# Autodesk Inventor assembly: balustrada_pe_patrat
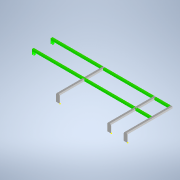
[picture p0: Inventor's stored thumbnail of the model, 180x180]
Saved by Autodesk Inventor 2022.6 (Build 266554000, 554)
## iProperties
Created: 2026-11-03
Part Number: balustrada_pe_patrat
Document SubType Name: Assembly
Designer: Dragos Macovei
Author: Dragos Macovei
## Documents named in this file (3)
- C:\Users\Dragos Macovei\Documents\3D_Parts\PAT ADI\balustrada_pe_patrat.iam
- C:\Users\Dragos Macovei\Documents\3D_Parts\PAT ADI\suport_balustrada.ipt
- C:\Users\Dragos Macovei\Documents\3D_Parts\PAT ADI\suport_balustrada_orizontala.ipt
## Components (5 placed, 2 different names)
1. suport_balustrada:1 — Flush:1, Flush:2, Flush:9, Flush:10, Flush:12
2. suport_balustrada:2 — Flush:1, Flush:3, Flush:4, Flush:5, Flush:9, Flush:11, Flush:13
3. suport_balustrada_orizontala:1 — Flush:3, Flush:8, Flush:13, Flush:14
4. suport_balustrada_orizontala:2 — Flush:4, Flush:5, Flush:6, Flush:7, Flush:8, Flush:11, Flush:12, Flush:14
5. suport_balustrada:3 — Flush:2, Flush:6, Flush:7, Flush:10
## Relationships (14: Flush 14)
- Flush:1: suport_balustrada:1 ↔ suport_balustrada:2
- Flush:2: suport_balustrada:1 ↔ suport_balustrada:3
- Flush:3: suport_balustrada:2 ↔ suport_balustrada_orizontala:1
- Flush:4: suport_balustrada:2 ↔ suport_balustrada_orizontala:2
- Flush:5: suport_balustrada:2 ↔ suport_balustrada_orizontala:2
- Flush:6: suport_balustrada_orizontala:2 ↔ suport_balustrada:3
- Flush:7: suport_balustrada_orizontala:2 ↔ suport_balustrada:3
- Flush:8: suport_balustrada_orizontala:1 ↔ suport_balustrada_orizontala:2
- Flush:9: suport_balustrada:1 ↔ suport_balustrada:2
- Flush:10: suport_balustrada:1 ↔ suport_balustrada:3
- Flush:11 (674 mm): suport_balustrada:2 ↔ suport_balustrada_orizontala:2
- Flush:12 (1356 mm): suport_balustrada:1 ↔ suport_balustrada_orizontala:2
- Flush:13 (360 mm): suport_balustrada:2 ↔ suport_balustrada_orizontala:1
- Flush:14: suport_balustrada_orizontala:1 ↔ suport_balustrada_orizontala:2
